# Autodesk Inventor assembly: BuckConverter_LM2596_Assembly
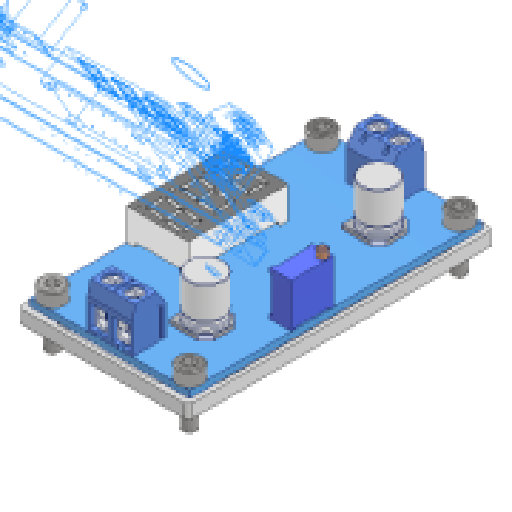
[picture p0: Inventor's stored thumbnail of the model, 512x512]
Saved by Autodesk Inventor 2025 (Build 290162000, 162)
## iProperties
Created: 2024-11-14
Part Number: BuckConverter_LM2596_Assembly
Document SubType Name: Assembly
Designer: OSB
Mass: 22 g
Surface Area: 134.343 cm^2
Volume: 9.72734 cm^3
Sending System: Autodesk Inventor 2021
Preprocessor: unknown
Minimum Resolution: 0.01
Sent Units: Millimeter
Translation Standard: IGES 5.3
Model Creation Time: 2020-07-07
Title: S500 Frame
Author: OSB
## Documents named in this file (4)
- C:\Users\OSB\Desktop\SB\1.Projects\캡스톤 디자인(2)_Paper\Modeling\Implementation_Design\Ver_004_mass_update\BuckConverter_LM2596_Assembly.iam
- C:\Users\OSB\Desktop\SB\1.Projects\캡스톤 디자인(2)_Paper\Modeling\Implementation_Design\Ver_004_mass_update\BuckConverter_LM2596_Module.ipt
- C:\Users\OSB\Desktop\SB\1.Projects\캡스톤 디자인(2)_Paper\Modeling\Implementation_Design\Ver_004_mass_update\BuckConverter_LM2596_Spacer.ipt
- C:\Users\OSB\Documents\Inventor\Content Center Files\R2025\ko-KR\KS B 1003\KS B 1003 - M 3 x 10.ipt
## Components (6 placed, 3 different names)
1. BuckConverter_LM2596_Module:1 — 회전:1, 메이트:1, 삽입:1, 삽입:2, 삽입:3, 삽입:4
2. BuckConverter_LM2596_Spacer:1 — 회전:1, 메이트:1
3. KS B 1003 - 미터 M 3 x 10:1 — 삽입:1
4. KS B 1003 - 미터 M 3 x 10:2 — 삽입:2
5. KS B 1003 - 미터 M 3 x 10:3 — 삽입:3
6. KS B 1003 - 미터 M 3 x 10:4 — 삽입:4
## Relationships (6: Insert 4, RevoluteJoint 1, Mate 1)
- 회전:1 [RevoluteJoint]: BuckConverter_LM2596_Module:1 ↔ BuckConverter_LM2596_Spacer:1
- 메이트:1 [Mate]: BuckConverter_LM2596_Module:1 ↔ BuckConverter_LM2596_Spacer:1
- 삽입:1 [Insert]: BuckConverter_LM2596_Module:1 ↔ KS B 1003 - 미터 M 3 x 10:1
- 삽입:2 [Insert]: BuckConverter_LM2596_Module:1 ↔ KS B 1003 - 미터 M 3 x 10:2
- 삽입:3 [Insert]: BuckConverter_LM2596_Module:1 ↔ KS B 1003 - 미터 M 3 x 10:3
- 삽입:4 [Insert]: BuckConverter_LM2596_Module:1 ↔ KS B 1003 - 미터 M 3 x 10:4
